# Autodesk Inventor assembly: xh-expander-assembly 1
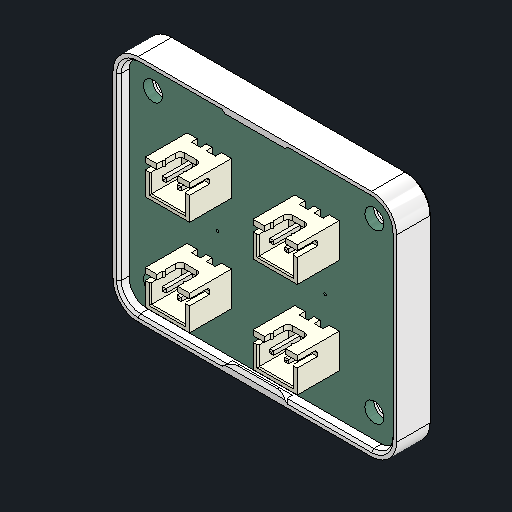
[picture p0: Inventor's stored thumbnail of the model, 512x512]
Saved by Autodesk Inventor 2027.1 (Build 311270010, 270A)
## iProperties
Company: Kicad
Created: 2026-11-03
Part Number: xh-expander-assembly 1
Description: KiCad electronic assembly
Document SubType Name: Assembly
Designer: queezz
Authority: Unknown
Sending System: KiCad to STEP converter
Preprocessor: Open CASCADE STEP processor 7.9
Title: xh-expander-assembly.step
Author: Pcbnew
## Documents named in this file (5)
- C:\Users\queezz\Dropbox\Drawings\pihti-cad\ElectronicsBox\xh-expansion\xh-expander-assembly.iam
- C:\Users\queezz\Dropbox\Drawings\pihti-cad\ElectronicsBox\xh-expansion\xh-expander-assembly\JST_XH_B2B-XH-A_1x02_P2.50mm_Vertical.ipt
- C:\Users\queezz\Dropbox\Drawings\pihti-cad\ElectronicsBox\xh-expansion\xh-expander-assembly\xh-expander_PCB.ipt
- C:\Users\queezz\Dropbox\Drawings\pihti-cad\ElectronicsBox\xh-expansion\xh-expansion-cover.ipt
- C:\Users\queezz\Dropbox\Drawings\pihti-cad\ElectronicsBox\xh-expansion\xh-cover.ipt
## Components (7 placed, 7 different names)
1. 1
2. 2
3. 3
4. 4
5. 5 — Flush:1, Flush:2, Rigid:1
6. xh-expansion-cover:1 — Flush:1, Flush:2
7. xh-cover:1 — Rigid:1
## Relationships (3: Flush 2, WeldJoint 1)
- Flush:1: 5 ↔ xh-expansion-cover:1
- Flush:2: 5 ↔ xh-expansion-cover:1
- Rigid:1 [WeldJoint] (3 mm): 5 ↔ xh-cover:1
